# Autodesk Inventor assembly: Potikka
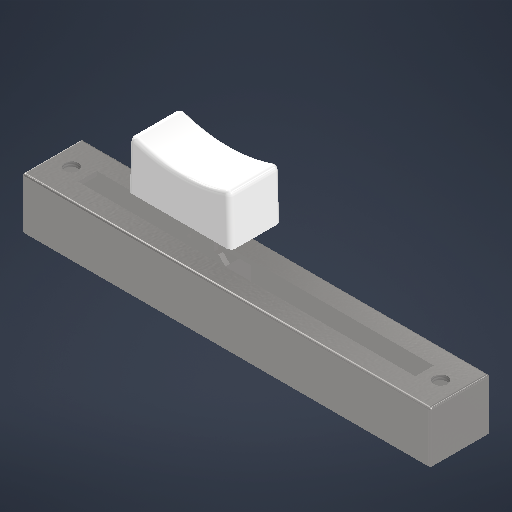
[picture p0: Inventor's stored thumbnail of the model, 512x512]
Saved by Autodesk Inventor 2026.1 (Build 301233020, 233B)
## iProperties
Created: 2025-11-03
Part Number: Potikka
Document SubType Name: Assembly
Designer: kuuse
Author: kuuse
## Documents named in this file (4)
- C:\Users\kuuse\OneDrive - Kaakkois-Suomen ammattikorkeakoulu Oy\Inventor\MekSu Robotti\Potikka.iam
- C:\Users\kuuse\OneDrive - Kaakkois-Suomen ammattikorkeakoulu Oy\Inventor\MekSu Robotti\Potikan runko.ipt
- C:\Users\kuuse\OneDrive - Kaakkois-Suomen ammattikorkeakoulu Oy\Inventor\MekSu Robotti\Potikan liuku.ipt
- C:\Users\kuuse\OneDrive - Kaakkois-Suomen ammattikorkeakoulu Oy\Inventor\MekSu Robotti\Potikan nuppi.ipt
## Components (3 placed, 3 different names)
1. Potikan runko:1 — Flush:1, Flush:2
2. Potikan liuku:1 — Flush:1, Flush:2, Mate:1, Mate:2, Mate:3
3. Potikan nuppi:1 — Mate:1, Mate:2, Mate:3
## Relationships (5: Mate 3, Flush 2)
- Flush:1: Potikan runko:1 ↔ Potikan liuku:1
- Flush:2: Potikan runko:1 ↔ Potikan liuku:1
- Mate:1: Potikan liuku:1 ↔ Potikan nuppi:1
- Mate:2: Potikan liuku:1 ↔ Potikan nuppi:1
- Mate:3: Potikan liuku:1 ↔ Potikan nuppi:1
